# Autodesk Inventor assembly: MONTAGEM
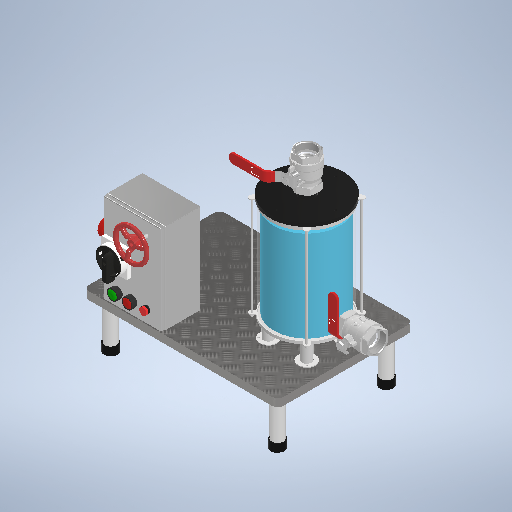
[picture p0: Inventor's stored thumbnail of the model, 512x512]
Saved by Autodesk Inventor 2025 (Build 290162000, 162)
## iProperties
Created: 2026-09-28
Part Number: MONTAGEM
Document SubType Name: Assembly
Designer: 34275214862
Author: 34275214862
## Documents named in this file (15)
- E:\SENAI\6º Semestre\CMVI - Tony\Montagem 3D\ESTACAO_NIVEL.iam
- E:\SENAI\6º Semestre\CMVI - Tony\Montagem 3D\SUPORTE DO TANQUE.ipt
- E:\SENAI\6º Semestre\CMVI - Tony\Montagem 3D\BASE.ipt
- E:\SENAI\6º Semestre\CMVI - Tony\Montagem 3D\QUADRO DE COMANDOS\QUADRO DE COMANDOS.iam
- E:\SENAI\6º Semestre\CMVI - Tony\Montagem 3D\BOTAO1.ipt
- E:\SENAI\6º Semestre\CMVI - Tony\Montagem 3D\BOTAO2.ipt
- E:\SENAI\6º Semestre\CMVI - Tony\Montagem 3D\LEDVM.ipt
- E:\SENAI\6º Semestre\CMVI - Tony\Montagem 3D\VOLANTE.ipt
- E:\SENAI\6º Semestre\CMVI - Tony\Montagem 3D\CHAVE SECCIONADORA ROTATIVA\CHAVE SECCIONADORA ROTATIVA.iam
- E:\SENAI\6º Semestre\CMVI - Tony\Montagem 3D\LIQUIDO.ipt
- E:\SENAI\6º Semestre\CMVI - Tony\Montagem 3D\TANQUE.ipt
- E:\SENAI\6º Semestre\CMVI - Tony\Montagem 3D\TAMPA.ipt
- E:\SENAI\6º Semestre\CMVI - Tony\Montagem 3D\VALVULA DE ESFERA 1.1-2'' INOX\VALVULA DE ESFERA 1.1-2'' INOX.iam
- E:\SENAI\6º Semestre\CMVI - Tony\Montagem 3D\PRENSA CABO - 3-8 - PG9.ipt
- E:\SENAI\6º Semestre\CMVI - Tony\Montagem 3D\BOTAO DE EMERGENCIA.ipt
## Components (15 placed, 14 different names)
1. BASE:1 — Mate:1, Flush:2, Flush:3, Mate:4, Flush:4, Flush:5, Angle:5, Angle:6
2. SUPORTE DO TANQUE:1 — Mate:1, Flush:2, Flush:3, Insert:8, Insert:9, Flush:6
3. QUADRO DE COMANDOS:1 [sub-assembly] — Mate:4, Insert:1, Insert:2, Insert:3, Insert:4, Insert:5, Flush:4, Flush:5, Insert:13, Insert:14, Angle:1, Angle:2, Angle:3, Angle:4, Angle:7, Angle:8
4. BOTAO1:1 — Insert:3, Angle:1
5. BOTAO2:1 — Insert:4, Angle:2
6. LEDVM:1 — Insert:5, Angle:3
7. VOLANTE:1 — Insert:2
8. CHAVE SECCIONADORA ROTATIVA:1 [sub-assembly] — Insert:1, Angle:4
9. LIQUIDO:1 — Insert:7, Mate:5
10. TANQUE:1 — Insert:7, Insert:8, Flush:6, Insert:12, Mate:5, Flush:7
11. TAMPA:1 — Insert:9, Insert:11, Flush:7
12. VALVULA DE ESFERA 1.1-2'' INOX:1 [sub-assembly] — Insert:12, Angle:6
13. VALVULA DE ESFERA 1.1-2'' INOX:2 [sub-assembly] — Insert:11, Angle:5
14. PRENSA CABO - 3-8 - PG9:1 — Insert:14, Angle:7
15. BOTAO DE EMERGENCIA:1 — Insert:13, Angle:8
## Relationships (29: Insert 12, Angle 8, Flush 6, Mate 3)
- Mate:1: BASE:1 ↔ SUPORTE DO TANQUE:1
- Flush:2 (100 mm): BASE:1 ↔ SUPORTE DO TANQUE:1
- Flush:3: BASE:1 ↔ SUPORTE DO TANQUE:1
- Mate:4: BASE:1 ↔ QUADRO DE COMANDOS:1
- Insert:1: QUADRO DE COMANDOS:1 ↔ CHAVE SECCIONADORA ROTATIVA:1
- Insert:2 (20 mm): QUADRO DE COMANDOS:1 ↔ VOLANTE:1
- Insert:3: QUADRO DE COMANDOS:1 ↔ BOTAO1:1
- Insert:4: QUADRO DE COMANDOS:1 ↔ BOTAO2:1
- Insert:5: QUADRO DE COMANDOS:1 ↔ LEDVM:1
- Flush:4 (50 mm): BASE:1 ↔ QUADRO DE COMANDOS:1
- Flush:5: BASE:1 ↔ QUADRO DE COMANDOS:1
- Insert:7: LIQUIDO:1 ↔ TANQUE:1
- Insert:8: SUPORTE DO TANQUE:1 ↔ TANQUE:1
- Insert:9: SUPORTE DO TANQUE:1 ↔ TAMPA:1
- Flush:6: SUPORTE DO TANQUE:1 ↔ TANQUE:1
- Insert:11: TAMPA:1 ↔ VALVULA DE ESFERA 1.1-2'' INOX:2
- Insert:12 (10 mm): TANQUE:1 ↔ VALVULA DE ESFERA 1.1-2'' INOX:1
- Insert:13: QUADRO DE COMANDOS:1 ↔ BOTAO DE EMERGENCIA:1
- Insert:14: QUADRO DE COMANDOS:1 ↔ PRENSA CABO - 3-8 - PG9:1
- Mate:5: LIQUIDO:1 ↔ TANQUE:1
- Angle:1 (0 deg): QUADRO DE COMANDOS:1 ↔ BOTAO1:1
- Angle:2 (0 deg): QUADRO DE COMANDOS:1 ↔ BOTAO2:1
- Angle:3 (0 deg): QUADRO DE COMANDOS:1 ↔ LEDVM:1
- Angle:4 (0 deg): QUADRO DE COMANDOS:1 ↔ CHAVE SECCIONADORA ROTATIVA:1
- Flush:7: TANQUE:1 ↔ TAMPA:1
- Angle:5 (0 deg): BASE:1 ↔ VALVULA DE ESFERA 1.1-2'' INOX:2
- Angle:6 (0 deg): BASE:1 ↔ VALVULA DE ESFERA 1.1-2'' INOX:1
- Angle:7 (0 deg): QUADRO DE COMANDOS:1 ↔ PRENSA CABO - 3-8 - PG9:1
- Angle:8 (0 deg): QUADRO DE COMANDOS:1 ↔ BOTAO DE EMERGENCIA:1
